(part 1 of 3)
# Autodesk Inventor assembly: ASSEMBLY_DUT_Ant_Rotator
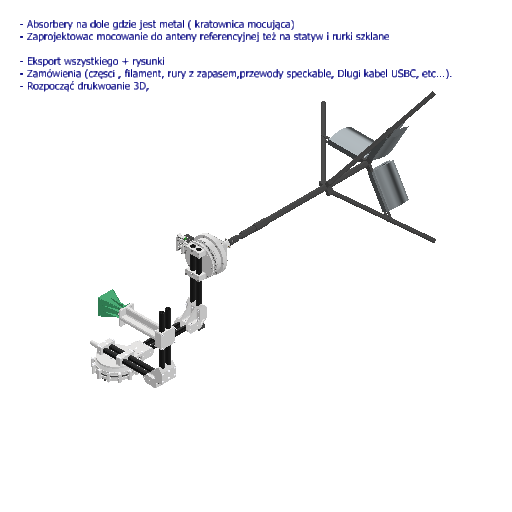
[picture p0: Inventor's stored thumbnail of the model, 512x512]
Saved by Autodesk Inventor 2027 (Build 310192060, 192F)
## iProperties
Created: 2026-01-06
Part Number: ASSEMBLY_DUT_Ant_Rotator
Document SubType Name: Assembly
Designer: User
Author: User
## Documents named in this file (62)
- C:\Users\lacze\OneDrive\_DRIVE_SYNCH_FILES\RF - Antenna Positioner\MCAD\1_V1\ASSEMBLY_DUT_ANT_POSITIONER_REVA\ASSEMBLY_DUT_Ant_Positioner.iam
- C:\Users\lacze\OneDrive\_DRIVE_SYNCH_FILES\RF - Antenna Positioner\MCAD\1_V1\__COTS_PARTS\COTS_CARBONCENTER_Fiberglass_Tube_27x24x383mm.ipt
- C:\Users\lacze\OneDrive\_DRIVE_SYNCH_FILES\RF - Antenna Positioner\MCAD\1_V1\__COTS_PARTS\COTS_GENERIC_6020_2RS_150x100x24mm_Ball_Bearing\COTS_GENERIC_6020_2RS_150x100x24mm_Ball_Bearing.ipt
- C:\Users\lacze\OneDrive\_DRIVE_SYNCH_FILES\RF - Antenna Positioner\MCAD\1_V1\ASSEMBLY_DUT_ANT_POSITIONER_REVA\3DP_PLA_A_Axis_Bearing_Base.ipt
- C:\Users\lacze\OneDrive\_DRIVE_SYNCH_FILES\RF - Antenna Positioner\MCAD\1_V1\ASSEMBLY_DUT_ANT_POSITIONER_REVA\3DP_PLA_A_Axis_Bearing_Base_Bearing_Locking_Ring.ipt
- C:\Users\lacze\OneDrive\_DRIVE_SYNCH_FILES\RF - Antenna Positioner\MCAD\1_V1\__CONTENT_CENTER_PARTS\en-US\ISO 7380-1\ISO 7380-1 - M4 x 40.ipt
- C:\Users\lacze\OneDrive\_DRIVE_SYNCH_FILES\RF - Antenna Positioner\MCAD\1_V1\__CONTENT_CENTER_PARTS\en-US\DIN 934\DIN 934 - M4 x 0,7.ipt
- C:\Users\lacze\OneDrive\_DRIVE_SYNCH_FILES\RF - Antenna Positioner\MCAD\1_V1\ASSEMBLY_DUT_ANT_POSITIONER_REVA\3DP_PLA_A_Axis_Rotating_Stage.ipt
- C:\Users\lacze\OneDrive\_DRIVE_SYNCH_FILES\RF - Antenna Positioner\MCAD\1_V1\ASSEMBLY_DUT_ANT_POSITIONER_REVA\3DP_PLA_A_Axis_Rotating_Stage_Mounting_Plate.ipt
- C:\Users\lacze\OneDrive\_DRIVE_SYNCH_FILES\RF - Antenna Positioner\MCAD\1_V1\__CONTENT_CENTER_PARTS\en-US\DIN 912\DIN 912 - M5 x 0,8 x 50 x 22.ipt
- C:\Users\lacze\OneDrive\_DRIVE_SYNCH_FILES\RF - Antenna Positioner\MCAD\1_V1\__CONTENT_CENTER_PARTS\en-US\DIN 934\DIN 934 - M5 x 0,8.ipt
- C:\Users\lacze\OneDrive\_DRIVE_SYNCH_FILES\RF - Antenna Positioner\MCAD\1_V1\__COTS_PARTS\COTS_GENERIC_HTD3M_24T_6mm_5mm_shaft_pulley.ipt
- C:\Users\lacze\OneDrive\_DRIVE_SYNCH_FILES\RF - Antenna Positioner\MCAD\1_V1\__COTS_PARTS\COTS_GENERIC_HTD3M_6mm_675mm_Closed_belt_A_Axis.ipt
- C:\Users\lacze\OneDrive\_DRIVE_SYNCH_FILES\RF - Antenna Positioner\MCAD\1_V1\ASSEMBLY_DUT_ANT_POSITIONER_REVA\3DP_PLA_A_Axis_Stepper_Mount.ipt
- C:\Users\lacze\OneDrive\_DRIVE_SYNCH_FILES\RF - Antenna Positioner\MCAD\1_V1\ASSEMBLY_DUT_ANT_POSITIONER_REVA\ASSEMBLY_HTD3M_Idler_A_Axis.iam
- C:\Users\lacze\OneDrive\_DRIVE_SYNCH_FILES\RF - Antenna Positioner\MCAD\1_V1\__CONTENT_CENTER_PARTS\en-US\DIN 125-1  A\DIN 125 - A 3,2.ipt
- C:\Users\lacze\OneDrive\_DRIVE_SYNCH_FILES\RF - Antenna Positioner\MCAD\1_V1\__CONTENT_CENTER_PARTS\en-US\ISO 7380-1\ISO 7380-1 - M3 x 16.ipt
- C:\Users\lacze\OneDrive\_DRIVE_SYNCH_FILES\RF - Antenna Positioner\MCAD\1_V1\ASSEMBLY_DUT_ANT_POSITIONER_REVA\3DP_PLA_A_Axis_Rotating_Stage_Fiberglass_pipes_mount_plate.ipt
- C:\Users\lacze\OneDrive\_DRIVE_SYNCH_FILES\RF - Antenna Positioner\MCAD\1_V1\ASSEMBLY_DUT_ANT_POSITIONER_REVA\3DP_PLA_A_Axis_Rotating_Stage_Fiberglass_pipes_mount_clamp.ipt
- C:\Users\lacze\OneDrive\_DRIVE_SYNCH_FILES\RF - Antenna Positioner\MCAD\1_V1\__CONTENT_CENTER_PARTS\en-US\DIN 912\DIN 912 - M4 x 0,7 x 20 x 18,25.ipt
- C:\Users\lacze\OneDrive\_DRIVE_SYNCH_FILES\RF - Antenna Positioner\MCAD\1_V1\__COTS_PARTS\COTS_MKS_SERVO42D_40mm.ipt
- C:\Users\lacze\OneDrive\_DRIVE_SYNCH_FILES\RF - Antenna Positioner\MCAD\1_V1\ASSEMBLY_DUT_ANT_POSITIONER_REVA\3DP_PLA_Fiberglass_Pipe_Corner_Bracket.ipt
- C:\Users\lacze\OneDrive\_DRIVE_SYNCH_FILES\RF - Antenna Positioner\MCAD\1_V1\ASSEMBLY_DUT_ANT_POSITIONER_REVA\3DP_PLA_Fiberglass_Pipe_Corner_Bracket_Clamp.ipt
- C:\Users\lacze\OneDrive\_DRIVE_SYNCH_FILES\RF - Antenna Positioner\MCAD\1_V1\__COTS_PARTS\COTS_DREMEC_8G206M6X50_M6x50_Nylon_Screw.ipt
- COTS_DREMEC_8G206M6X50_M6x50_Nylon_Screw.ipt
- C:\Users\lacze\OneDrive\_DRIVE_SYNCH_FILES\RF - Antenna Positioner\MCAD\1_V1\__COTS_PARTS\COTS_BOSSARD_1400444_M6_Nylon_Nut.ipt
- C:\Users\lacze\OneDrive\_DRIVE_SYNCH_FILES\RF - Antenna Positioner\MCAD\1_V1\ASSEMBLY_DUT_ANT_POSITIONER_REVA\3DP_PLA_Fiberglass_Pipe_Corner_Bracket_Clamp_and_B_axis_Stepper_Mount.ipt
- C:\Users\lacze\OneDrive\_DRIVE_SYNCH_FILES\RF - Antenna Positioner\MCAD\1_V1\__COTS_PARTS\COTS_GENERIC_HTD3M_20T_6mm_5mm_shaft_pulley.ipt
- C:\Users\lacze\OneDrive\_DRIVE_SYNCH_FILES\RF - Antenna Positioner\MCAD\1_V1\ASSEMBLY_DUT_ANT_POSITIONER_REVA\3DP_PLA_B_Axis_Main_Pulley.ipt
- C:\Users\lacze\OneDrive\_DRIVE_SYNCH_FILES\RF - Antenna Positioner\MCAD\1_V1\ASSEMBLY_DUT_ANT_POSITIONER_REVA\ASSEMBLY_HTD3M_Idler_B_Axis.iam
- C:\Users\lacze\OneDrive\_DRIVE_SYNCH_FILES\RF - Antenna Positioner\MCAD\1_V1\__COTS_PARTS\COTS_GENERIC_HTD3M_6mm_1530mm_Closed_belt_B_Axis.ipt
- C:\Users\lacze\OneDrive\_DRIVE_SYNCH_FILES\RF - Antenna Positioner\MCAD\1_V1\__CONTENT_CENTER_PARTS\en-US\DIN 912\DIN 912 - M4 x 0,7 x 35 x 20.ipt
- C:\Users\lacze\OneDrive\_DRIVE_SYNCH_FILES\RF - Antenna Positioner\MCAD\1_V1\__COTS_PARTS\COTS_GENERIC_6016_80x125x22mm_POM_Ball_Bearing\COTS_GENERIC_6016_80x125x22mm_POM_Ball_Bearing.ipt
- C:\Users\lacze\OneDrive\_DRIVE_SYNCH_FILES\RF - Antenna Positioner\MCAD\1_V1\ASSEMBLY_DUT_ANT_POSITIONER_REVA\3DP_PLA_B_Axis_Bearing_Mounting_Plate.ipt
- C:\Users\lacze\OneDrive\_DRIVE_SYNCH_FILES\RF - Antenna Positioner\MCAD\1_V1\ASSEMBLY_DUT_ANT_POSITIONER_REVA\ASSEMBLY_HTD3M_Idler_B_Axis_Top.iam
- C:\Users\lacze\OneDrive\_DRIVE_SYNCH_FILES\RF - Antenna Positioner\MCAD\1_V1\__COTS_PARTS\COTS_DREMEC_8G206V50126_M4x40_Nylon_Screw.ipt
- C:\Users\lacze\OneDrive\_DRIVE_SYNCH_FILES\RF - Antenna Positioner\MCAD\1_V1\__COTS_PARTS\COTS_BOSSARD_1400428_M4_Nylon_Nut.ipt
- C:\Users\lacze\OneDrive\_DRIVE_SYNCH_FILES\RF - Antenna Positioner\MCAD\1_V1\ASSEMBLY_DUT_ANT_POSITIONER_REVA\3DP_PLA_B_Axis_Rotating_Stage.ipt
- C:\Users\lacze\OneDrive\_DRIVE_SYNCH_FILES\RF - Antenna Positioner\MCAD\1_V1\__COTS_PARTS\COTS_BYTECHLAB_COAXIAL_FEED_HORN\COTS_BYTECHLAB_Coaxial_Feed_Horn.iam
- C:\Users\lacze\OneDrive\_DRIVE_SYNCH_FILES\RF - Antenna Positioner\MCAD\1_V1\ASSEMBLY_DUT_ANT_POSITIONER_REVA\3DP_PLA_B_Axis_Rotating_Stage_Fiberglass_pipes_mount_clamp.ipt
- C:\Users\lacze\OneDrive\_DRIVE_SYNCH_FILES\RF - Antenna Positioner\MCAD\1_V1\ASSEMBLY_DUT_ANT_POSITIONER_REVA\3DP_PLA_B_Axis_End_Cap.ipt
- C:\Users\lacze\OneDrive\_DRIVE_SYNCH_FILES\RF - Antenna Positioner\MCAD\1_V1\ASSEMBLY_DUT_ANT_POSITIONER_REVA\3DP_PLA_Antenna_Boom_Coax_Feed_Horn.ipt
- C:\Users\lacze\OneDrive\_DRIVE_SYNCH_FILES\RF - Antenna Positioner\MCAD\1_V1\ASSEMBLY_DUT_ANT_POSITIONER_REVA\3DP_PLA_Antenna_Boom_Fiberglass_Pipe_Clamp.ipt
- C:\Users\lacze\OneDrive\_DRIVE_SYNCH_FILES\RF - Antenna Positioner\MCAD\1_V1\__COTS_PARTS\COTS_GlareOne_A-275_Tripod\COTS_GlareOne_A-275_Tripod.iam
- C:\Users\lacze\OneDrive\_DRIVE_SYNCH_FILES\RF - Antenna Positioner\MCAD\1_V1\ASSEMBLY_DUT_ANT_POSITIONER_REVA\3DP_PLA_A_Axis_Bearing_Base_Tripod_Mount.ipt
- C:\Users\lacze\OneDrive\_DRIVE_SYNCH_FILES\RF - Antenna Positioner\MCAD\1_V1\__CONTENT_CENTER_PARTS\en-US\DIN 912\DIN 912 - M5 x 0,8 x 30 x 22.ipt
- C:\Users\lacze\OneDrive\_DRIVE_SYNCH_FILES\RF - Antenna Positioner\MCAD\1_V1\__COTS_PARTS\COTS_BOSSARD_1386786_M5_Threaded_Insert.ipt
- C:\Users\lacze\OneDrive\_DRIVE_SYNCH_FILES\RF - Antenna Positioner\MCAD\1_V1\__CONTENT_CENTER_PARTS\en-US\DIN 912\DIN 912 - M5 x 0,8 x 20 x 18.ipt
- C:\Users\lacze\OneDrive\_DRIVE_SYNCH_FILES\RF - Antenna Positioner\MCAD\1_V1\__COTS_PARTS\COTS_PROFOTO_Tripod_Sandbag.ipt
- C:\Users\lacze\OneDrive\_DRIVE_SYNCH_FILES\RF - Antenna Positioner\MCAD\1_V1\__COTS_PARTS\COTS_MKS_Cacable_1_0_PRO.ipt
- C:\Users\lacze\OneDrive\_DRIVE_SYNCH_FILES\RF - Antenna Positioner\MCAD\1_V1\__COTS_PARTS\COTS_GENERIC_5.6mm_DC_Jack.ipt
- C:\Users\lacze\OneDrive\_DRIVE_SYNCH_FILES\RF - Antenna Positioner\MCAD\1_V1\__COTS_PARTS\COTS_Profihot_HC-2-22x16_Zip_Tie_Anchor.ipt
- C:\Users\lacze\OneDrive\_DRIVE_SYNCH_FILES\RF - Antenna Positioner\MCAD\1_V1\__COTS_PARTS\COTS_BOSSARD_1386883_M4_Threaded_Insert\COTS_BOSSARD_1386883_M4_Threaded_Insert.ipt
- C:\Users\lacze\OneDrive\_DRIVE_SYNCH_FILES\RF - Antenna Positioner\MCAD\1_V1\__CONTENT_CENTER_PARTS\en-US\DIN 125-1  A\DIN 125 - A 4,3.ipt
- C:\Users\lacze\OneDrive\_DRIVE_SYNCH_FILES\RF - Antenna Positioner\MCAD\1_V1\__CONTENT_CENTER_PARTS\en-US\ISO 7380-1\ISO 7380-1 - M4 x 8.ipt
- C:\Users\lacze\OneDrive\_DRIVE_SYNCH_FILES\RF - Antenna Positioner\MCAD\1_V1\__CONTENT_CENTER_PARTS\en-US\ISO 7380-1\ISO 7380-1 - M4 x 16.ipt
- C:\Users\lacze\OneDrive\_DRIVE_SYNCH_FILES\RF - Antenna Positioner\MCAD\1_V1\__COTS_PARTS\COTS_DREMEC_8G206M5X08_M5x8_Nylon_Screw.ipt
- C:\Users\lacze\OneDrive\_DRIVE_SYNCH_FILES\RF - Antenna Positioner\MCAD\1_V1\ASSEMBLY_DUT_ANT_POSITIONER_REVA\3DP_PLA_B_Axis_Cable_Galnd.ipt
- C:\Users\lacze\OneDrive\_DRIVE_SYNCH_FILES\RF - Antenna Positioner\MCAD\1_V1\ASSEMBLY_DUT_ANT_POSITIONER_REVA\3DP_PLA_A_Axis_Idler_Stiffening_Bracket.ipt
- C:\Users\lacze\OneDrive\_DRIVE_SYNCH_FILES\RF - Antenna Positioner\MCAD\1_V1\ASSEMBLY_DUT_ANT_POSITIONER_REVA\3DP_PLA_B_Axis_Idler_Stiffening_Bracket.ipt
- C:\Users\lacze\OneDrive\_DRIVE_SYNCH_FILES\RF - Antenna Positioner\MCAD\1_V1\ASSEMBLY_DUT_ANT_POSITIONER_REVA\3DP_PLA_CANable_Mounting_Plate.ipt
- C:\Users\lacze\OneDrive\_DRIVE_SYNCH_FILES\RF - Antenna Positioner\MCAD\1_V1\__CONTENT_CENTER_PARTS\en-US\DIN 912\DIN 912 - M2 x 0,4 x 16 x 15.ipt
## Components (333 placed, 60 different names)
1. COTS_CARBONCENTER_Fiberglass_Tube_27x24x383mm:1 — Mate:124, Flush:1, Mate:210, Mate:214
2. COTS_GENERIC_6020_2RS_150x100x24mm_Ball_Bearing:1 — Mate:3, Mate:4, Mate:40, Mate:41, Mate:42, Mate:43
3. 3DP_PLA_A_Axis_Bearing_Base:1 — Mate:1, Mate:2, Mate:3, Mate:4, Mate:5, Mate:6, Mate:7, Mate:25, Mate:27, Mate:29, Mate:31, Mate:33, Mate:35, Mate:37, Mate:39, Angle:1, Angle:2, Angle:3, Angle:4, Angle:5, Angle:6, Angle:7, Angle:8, Angle:17, Mate:80, Mate:81, Mate:82, Mate:90, Mate:92, Mate:94, Angle:18, Angle:19, Angle:20, Mate:523, Mate:524, Mate:525, Mate:530, Mate:532, Mate:534, Mate:536, Mate:538, Mate:540, Mate:543, Mate:544, Mate:545, Mate:546, Mate:547, Mate:548, Mate:549, Mate:550, Mate:551, Mate:552, Mate:553, Mate:554, Mate:555, Mate:576, Angle:64, Mate:577, Flush:24, Angle:67
4. 3DP_PLA_A_Axis_Bearing_Base_Bearing_Locking_Ring:1 — Mate:5, Mate:6, Mate:7, Mate:8, Mate:9, Mate:10, Mate:11, Mate:12, Mate:13, Mate:14, Mate:15, Mate:16, Mate:17, Mate:18, Mate:19, Mate:20, Mate:21, Mate:22, Mate:23, Mate:24, Mate:26, Mate:28, Mate:30, Mate:32, Mate:34, Mate:36, Mate:38
5. COTS_MKS_SERVO42D_40mm:1 — Mate:77, Mate:107, Mate:108, Mate:109, Mate:110, Mate:112, Mate:114, Mate:116
6. 3DP_PLA_A_Axis_Rotating_Stage:1 — Mate:40, Mate:41, Mate:44, Mate:45, Mate:46, Mate:47, Mate:48, Mate:49, Mate:50, Mate:51, Mate:52, Mate:53, Mate:54, Mate:55, Mate:56, Mate:57, Mate:58, Mate:59, Mate:60, Mate:61, Mate:63, Mate:65, Mate:67, Mate:69, Mate:71, Mate:73, Mate:75, Mate:78, Mate:79, Mate:121, Mate:122, Mate:123, Mate:194, Mate:196, Mate:198, Mate:200, Mate:202, Mate:204, Mate:206, Mate:208, Angle:33, Angle:34, Angle:35, Angle:36, Angle:37, Angle:38, Angle:39, Angle:40
7. 3DP_PLA_A_Axis_Rotating_Stage_Mounting_Plate:1 — Mate:42, Mate:43, Mate:44, Mate:62, Mate:64, Mate:66, Mate:68, Mate:70, Mate:72, Mate:74, Mate:76, Angle:9, Angle:10, Angle:11, Angle:12, Angle:13, Angle:14, Angle:15, Angle:16
8. COTS_GENERIC_HTD3M_24T_6mm_5mm_shaft_pulley:1 — Mate:77, Mate:118, Mate:119
9. COTS_GENERIC_HTD3M_6mm_675mm_Closed_belt_A_Axis:1 — Mate:78, Mate:79, Mate:118, Mate:119
10. 3DP_PLA_A_Axis_Stepper_Mount:1 — Mate:80, Mate:81, Mate:82, Mate:83, Mate:84, Mate:85, Mate:86, Mate:87, Mate:88, Mate:89, Mate:91, Mate:93, Mate:95, Mate:96, Mate:97, Mate:98, Mate:107, Mate:108, Mate:109, Mate:111, Mate:113, Mate:115, Mate:117, Mate:563, Mate:564, Mate:565, Mate:574, Mate:575, Mate:600, Mate:602, Mate:616
11. ASSEMBLY_HTD3M_Idler_A_Axis:1 [sub-assembly] — Mate:96, Mate:98, Mate:594
12. ASSEMBLY_HTD3M_Idler_A_Axis:2 [sub-assembly] — Mate:95, Mate:97, Mate:592, Mate:593
13. 3DP_PLA_A_Axis_Rotating_Stage_Fiberglass_pipes_mount_plate:1 — Mate:121, Mate:122, Mate:123, Mate:124, Flush:1, Mate:125, Flush:2, Mate:127, Mate:128, Flush:3, Flush:4, Flush:5, Flush:6, Mate:154, Mate:156, Mate:158, Mate:160, Mate:162, Mate:164, Mate:166, Mate:168, Mate:170, Mate:172, Mate:174, Mate:176, Angle:21, Angle:22, Angle:23, Angle:24, Angle:25, Angle:26, Angle:27, Angle:28, Angle:29, Angle:30, Angle:31, Angle:32, Mate:177, Mate:178, Mate:179, Mate:180, Mate:181, Mate:182, Mate:183, Mate:184, Mate:185, Mate:186, Mate:187, Mate:188, Mate:189, Mate:190, Mate:191, Mate:192, Mate:193, Mate:195, Mate:197, Mate:199, Mate:201, Mate:203, Mate:205, Mate:207, Angle:41
14. COTS_CARBONCENTER_Fiberglass_Tube_27x24x383mm:2 — Mate:125, Flush:2, Mate:209, Mate:213, Flush:7
15. COTS_CARBONCENTER_Fiberglass_Tube_27x24x383mm:3 — Mate:211, Mate:240, Mate:242, Angle:42
16. 3DP_PLA_A_Axis_Rotating_Stage_Fiberglass_pipes_mount_clamp:1 — Mate:128, Flush:5, Flush:6, Mate:141, Mate:143, Mate:145, Mate:147, Mate:149, Mate:151, Mate:165, Mate:167, Mate:169, Mate:171, Mate:173, Mate:175
17. 3DP_PLA_A_Axis_Rotating_Stage_Fiberglass_pipes_mount_clamp:2 — Mate:127, Flush:3, Flush:4, Mate:129, Mate:130, Mate:131, Mate:132, Mate:133, Mate:134, Mate:135, Mate:136, Mate:137, Mate:138, Mate:139, Mate:140, Mate:142, Mate:144, Mate:146, Mate:148, Mate:150, Mate:152, Mate:153, Mate:155, Mate:157, Mate:159, Mate:161, Mate:163
18. COTS_CARBONCENTER_Fiberglass_Tube_27x24x383mm:4 — Mate:212, Mate:241, Mate:243, Mate:411
19. COTS_CARBONCENTER_Fiberglass_Tube_27x24x383mm:5 — Mate:251, Mate:254, Flush:11, Mate:406, Flush:19, Mate:407, Mate:409, Mate:590, Mate:591
20. COTS_CARBONCENTER_Fiberglass_Tube_27x24x383mm:6 — Mate:250, Mate:255, Flush:12, Mate:405, Mate:408, Mate:410
21. COTS_CARBONCENTER_Fiberglass_Tube_27x24x383mm:7 — Mate:253, Mate:256, Flush:13, Mate:501, Mate:503
22. COTS_CARBONCENTER_Fiberglass_Tube_27x24x383mm:8 — Mate:252, Mate:257, Flush:14, Mate:500, Flush:22, Mate:502
23. 3DP_PLA_Fiberglass_Pipe_Corner_Bracket:1 — Mate:209, Mate:210, Mate:211, Mate:212, Mate:215, Mate:228, Mate:229, Mate:230, Mate:231, Mate:232, Mate:233, Mate:240, Mate:241, Mate:244, Mate:270, Mate:271, Mate:272, Mate:273, Mate:274, Mate:275
24. 3DP_PLA_Fiberglass_Pipe_Corner_Bracket_Clamp:1 — Mate:213, Mate:214, Mate:215, Mate:216, Mate:217, Mate:218, Mate:219, Mate:220, Mate:221, Mate:222, Mate:223, Mate:224, Mate:225, Mate:226, Mate:227, Flush:7
25. 3DP_PLA_Fiberglass_Pipe_Corner_Bracket_Clamp_and_B_axis_Stepper_Mount:1 — Mate:242, Mate:243, Mate:244, Mate:245, Mate:248, Mate:249, Flush:8, Mate:258, Mate:259, Mate:260, Mate:261, Mate:262, Mate:263, Mate:264, Mate:265, Mate:266, Mate:267, Mate:268, Mate:269, Mate:331, Mate:332, Mate:333, Mate:334, Mate:336, Mate:342, Mate:344, Mate:346, Mate:348, Angle:43, Mate:581, Mate:582, Mate:584, Mate:585, Mate:611, Mate:613
26. COTS_MKS_SERVO42D_40mm:2 — Mate:245, Mate:247, Mate:248, Mate:249, Mate:336, Mate:341, Mate:343, Mate:345, Mate:347, Angle:65
27. COTS_GENERIC_HTD3M_20T_6mm_5mm_shaft_pulley:1 — Mate:247, Flush:8, Mate:335, Mate:337
28. 3DP_PLA_Fiberglass_Pipe_Corner_Bracket:2 — Mate:250, Mate:251, Mate:252, Mate:253, Flush:9, Flush:10, Mate:306, Mate:307, Mate:308, Mate:309, Mate:310, Mate:311, Mate:312, Mate:313, Mate:314, Mate:315, Mate:316, Mate:317, Angle:54
29. 3DP_PLA_Fiberglass_Pipe_Corner_Bracket_Clamp:2 — Mate:254, Mate:255, Flush:10, Flush:11, Flush:12, Mate:282, Mate:283, Mate:284, Mate:285, Mate:286, Mate:287, Mate:300, Mate:301, Mate:302, Mate:303, Mate:304, Mate:305
30. 3DP_PLA_Fiberglass_Pipe_Corner_Bracket_Clamp:3 — Mate:256, Mate:257, Flush:9, Flush:13, Flush:14, Mate:288, Mate:289, Mate:290, Mate:291, Mate:292, Mate:293, Mate:294, Mate:295, Mate:296, Mate:297, Mate:298, Mate:299
31. 3DP_PLA_B_Axis_Main_Pulley:1 — Mate:339, Mate:340, Mate:357, Mate:358, Mate:359, Mate:360, Mate:404, Mate:460, Mate:461, Mate:462, Mate:463, Mate:464, Mate:465, Mate:466, Mate:467, Mate:468, Mate:469, Mate:470, Mate:471, Mate:472, Mate:486, Mate:487, Mate:488, Mate:489, Mate:490, Mate:491, Mate:492, Mate:493
32. ASSEMBLY_HTD3M_Idler_B_Axis:1 [sub-assembly] — Mate:331, Mate:334, Mate:605
33. ASSEMBLY_HTD3M_Idler_B_Axis:2 [sub-assembly] — Mate:332, Mate:333, Mate:603, Mate:604
34. COTS_GENERIC_HTD3M_6mm_1530mm_Closed_belt_B_Axis:1 — Mate:335, Mate:337, Mate:339, Mate:340, Angle:42
35. COTS_GENERIC_6016_80x125x22mm_POM_Ball_Bearing:1 — Mate:357, Mate:358, Flush:17, Mate:362, Mate:485
36. COTS_GENERIC_6016_80x125x22mm_POM_Ball_Bearing:2 — Mate:359, Mate:360, Mate:361, Flush:16, Mate:403
37. 3DP_PLA_B_Axis_Bearing_Mounting_Plate:1 — Mate:361, Flush:16, Angle:43, Flush:18, Mate:363, Mate:364, Mate:365, Mate:366, Mate:367, Mate:368, Mate:369, Mate:370, Mate:383, Mate:384, Mate:385, Mate:386, Mate:387, Mate:388, Mate:397, Mate:411, Angle:54
38. 3DP_PLA_B_Axis_Bearing_Mounting_Plate:2 — Flush:17, Mate:362, Flush:18, Mate:371, Mate:372, Mate:373, Mate:374, Mate:375, Mate:376, Mate:377, Mate:378, Mate:379, Mate:380, Mate:381, Mate:382, Mate:395, Mate:396, Mate:399, Mate:400, Mate:586, Angle:66, Mate:587, Mate:588
39. ASSEMBLY_HTD3M_Idler_B_Axis_Top:1 [sub-assembly] — Mate:363, Mate:365
40. ASSEMBLY_HTD3M_Idler_B_Axis_Top:2 [sub-assembly] — Mate:364, Mate:366
41. 3DP_PLA_B_Axis_Rotating_Stage:1 — Mate:403, Mate:404, Mate:405, Mate:406, Flush:19, Flush:20, Flush:21, Mate:436, Mate:437, Mate:438, Mate:439, Mate:440, Mate:441, Mate:442, Mate:443, Mate:444, Mate:445, Mate:446, Mate:447, Angle:44, Angle:45, Angle:46, Angle:47, Angle:48, Angle:49, Angle:50, Angle:51, Angle:52, Angle:53, Mate:460, Mate:473, Mate:474, Mate:475, Mate:476, Mate:477, Mate:478, Angle:55, Angle:56, Angle:57, Angle:58, Angle:59, Angle:60
42. COTS_BYTECHLAB_Coaxial_Feed_Horn:1 [sub-assembly] — Mate:520, Mate:521, Mate:522
43. 3DP_PLA_B_Axis_Rotating_Stage_Fiberglass_pipes_mount_clamp:1 — Mate:407, Mate:408, Flush:20, Mate:412, Mate:413, Mate:414, Mate:415, Mate:416, Mate:417, Mate:430, Mate:431, Mate:432, Mate:433, Mate:434, Mate:435
44. 3DP_PLA_B_Axis_Rotating_Stage_Fiberglass_pipes_mount_clamp:2 — Mate:409, Mate:410, Flush:21, Mate:418, Mate:419, Mate:420, Mate:421, Mate:422, Mate:423, Mate:424, Mate:425, Mate:426, Mate:427, Mate:428, Mate:429
45. 3DP_PLA_B_Axis_End_Cap:1 — Mate:485, Mate:486, Mate:487, Mate:494, Mate:495, Mate:496, Angle:61, Angle:62, Angle:63
46. 3DP_PLA_Antenna_Boom_Coax_Feed_Horn:1 — Mate:500, Mate:501, Flush:22, Flush:23, Mate:504, Mate:505, Mate:506, Mate:507, Mate:508, Mate:509, Mate:510, Mate:511, Mate:520, Mate:521, Mate:522
47. 3DP_PLA_Antenna_Boom_Fiberglass_Pipe_Clamp:1 — Mate:502, Mate:503, Flush:23, Mate:512, Mate:513, Mate:514, Mate:515
48. COTS_GlareOne_A-275_Tripod:1 [sub-assembly] — Mate:526, Mate:527, Mate:560, Mate:561, Mate:562, Angle:67
49. 3DP_PLA_A_Axis_Bearing_Base_Tripod_Mount:1 — Mate:523, Mate:524, Mate:525, Mate:526, Mate:527, Mate:528, Mate:529, Mate:531, Mate:533, Mate:535, Mate:537, Mate:539, Mate:541, Mate:542, Mate:556, Mate:557
50. COTS_MKS_Cacable_1_0_PRO:1 — Mate:563, Mate:564, Mate:565, Mate:614, Mate:615
51. COTS_GENERIC_5.6mm_DC_Jack:1 — Mate:574, Mate:575
52. COTS_Profihot_HC-2-22x16_Zip_Tie_Anchor:1 — Mate:576, Angle:64, Mate:578, Mate:579, Mate:580
53. COTS_Profihot_HC-2-22x16_Zip_Tie_Anchor:2 — Mate:581, Angle:65, Mate:583
54. COTS_Profihot_HC-2-22x16_Zip_Tie_Anchor:3 — Mate:586, Angle:66, Mate:587, Mate:589
55. COTS_DREMEC_8G206M5X08_M5x8_Nylon_Screw:1 — Mate:588, Mate:589
56. 3DP_PLA_B_Axis_Cable_Galnd:1 — Mate:590, Mate:591
57. 3DP_PLA_A_Axis_Idler_Stiffening_Bracket:1 — Mate:592, Mate:593, Mate:594, Mate:595, Mate:596, Mate:597, Mate:598, Mate:599, Mate:601
58. 3DP_PLA_B_Axis_Idler_Stiffening_Bracket:1 — Mate:603, Mate:604, Mate:605, Mate:606, Mate:607, Mate:608, Mate:609, Mate:610, Mate:612
59. 3DP_PLA_CANable_Mounting_Plate:1 — Mate:614, Mate:615, Mate:616, Mate:617, Mate:618, Mate:619, Mate:620, Mate:621, Mate:622, Mate:623, Mate:624
60. DIN 912 - replaced by DIN EN ISO 4762 M2 x 16:1 — Mate:617, Mate:618
61. DIN 912 - replaced by DIN EN ISO 4762 M2 x 16:2 — Mate:619, Mate:620
62. DIN 912 - replaced by DIN EN ISO 4762 M2 x 16:3 — Mate:621, Mate:622
63. DIN 912 - replaced by DIN EN ISO 4762 M2 x 16:4 — Mate:623, Mate:624
64. DIN 912 - replaced by DIN EN ISO 4762 M4 x 35:3 — Mate:595, Mate:596
65. DIN 934 - replaced by DIN EN 24032/28673/28674 M4:25 — Mate:599, Mate:600
66. DIN 912 - replaced by DIN EN ISO 4762 M4 x 35:4 — Mate:597, Mate:598
67. DIN 934 - replaced by DIN EN 24032/28673/28674 M4:26 — Mate:601, Mate:602
68. ISO 7380-1 M4 x 40:12 — Mate:606, Mate:607
69. DIN 934 - replaced by DIN EN 24032/28673/28674 M4:27 — Mate:610, Mate:611
70. ISO 7380-1 M4 x 40:13 — Mate:608, Mate:609
71. DIN 934 - replaced by DIN EN 24032/28673/28674 M4:28 — Mate:612, Mate:613
72. COTS_BOSSARD_1386883_M4_Threaded_Insert:1 — Mate:577, Flush:24, Mate:578
73. DIN 125-1 A A 4,3:1 — Mate:579, Mate:580, Insert:9
74. ISO 7380-1 M4 x 8:1 — Insert:9
75. DIN 125-1 A A 4,3:2 — Mate:582, Mate:583, Insert:10
76. ISO 7380-1 M4 x 16:1 — Insert:10
77. DIN 125-1 A A 4,3:3 — Mate:584, Mate:585, Insert:11
78. DIN 934 - replaced by DIN EN 24032/28673/28674 M4:24 — Insert:11
79. DIN 934 - replaced by DIN EN 24032/28673/28674 M5:27 — Mate:554, Mate:555
80. DIN 934 - replaced by DIN EN 24032/28673/28674 M5:26 — Mate:552, Mate:553
81. DIN 934 - replaced by DIN EN 24032/28673/28674 M5:25 — Mate:550, Mate:551
82. DIN 934 - replaced by DIN EN 24032/28673/28674 M5:24 — Mate:548, Mate:549
83. DIN 934 - replaced by DIN EN 24032/28673/28674 M5:23 — Mate:546, Mate:547
84. DIN 934 - replaced by DIN EN 24032/28673/28674 M5:22 — Mate:544, Mate:545
85. DIN 912 - replaced by DIN EN ISO 4762 M5 x 30:7 — Mate:540, Mate:541
86. DIN 912 - replaced by DIN EN ISO 4762 M5 x 30:6 — Mate:538, Mate:539
87. DIN 912 - replaced by DIN EN ISO 4762 M5 x 30:5 — Mate:536, Mate:537
88. DIN 912 - replaced by DIN EN ISO 4762 M5 x 30:4 — Mate:534, Mate:535
89. DIN 912 - replaced by DIN EN ISO 4762 M5 x 30:3 — Mate:532, Mate:533
90. DIN 912 - replaced by DIN EN ISO 4762 M5 x 30:2 — Mate:530, Mate:531
91. DIN 934 - replaced by DIN EN 24032/28673/28674 M5:21 — Mate:542, Mate:543
92. DIN 912 - replaced by DIN EN ISO 4762 M5 x 30:1 — Mate:528, Mate:529
93. COTS_BOSSARD_1400444_M6_Nylon_Nut:66 — Mate:513, Mate:517
94. COTS_BOSSARD_1400444_M6_Nylon_Nut:65 — Mate:514, Mate:519
95. COTS_BOSSARD_1400444_M6_Nylon_Nut:64 — Mate:515, Mate:516
96. COTS_BOSSARD_1400444_M6_Nylon_Nut:63 — Mate:512, Mate:518
97. COTS_DREMEC_8G206M6X50_M6x50_Nylon_Screw:66 — Mate:507, Mate:508, Mate:516
98. COTS_DREMEC_8G206M6X50_M6x50_Nylon_Screw:65 — Mate:506, Mate:511, Mate:519
99. COTS_DREMEC_8G206M6X50_M6x50_Nylon_Screw:64 — Mate:505, Mate:509, Mate:517
100. COTS_DREMEC_8G206M6X50_M6x50_Nylon_Screw:63 — Mate:504, Mate:510, Mate:518
101. COTS_BOSSARD_1400444_M6_Nylon_Nut:62 — Mate:495, Mate:498, Angle:62
102. COTS_BOSSARD_1400444_M6_Nylon_Nut:61 — Mate:494, Mate:499, Angle:61
103. COTS_BOSSARD_1400444_M6_Nylon_Nut:60 — Mate:496, Mate:497, Angle:63
104. COTS_DREMEC_8G206M6X50_M6x50_Nylon_Screw:62 — Mate:488, Mate:493, Mate:497
105. COTS_DREMEC_8G206M6X50_M6x50_Nylon_Screw:61 — Mate:489, Mate:491, Mate:499
106. COTS_DREMEC_8G206M6X50_M6x50_Nylon_Screw:60 — Mate:490, Mate:492, Mate:498
107. COTS_BOSSARD_1400444_M6_Nylon_Nut:59 — Mate:477, Mate:479, Angle:60
108. COTS_BOSSARD_1400444_M6_Nylon_Nut:58 — Mate:478, Mate:480, Angle:59
109. COTS_BOSSARD_1400444_M6_Nylon_Nut:57 — Mate:476, Mate:484, Angle:58
110. COTS_BOSSARD_1400444_M6_Nylon_Nut:56 — Mate:475, Mate:483, Angle:57
111. COTS_BOSSARD_1400444_M6_Nylon_Nut:55 — Mate:473, Mate:481, Angle:55
112. COTS_BOSSARD_1400444_M6_Nylon_Nut:54 — Mate:474, Mate:482, Angle:56
113. COTS_DREMEC_8G206M6X50_M6x50_Nylon_Screw:59 — Mate:465, Mate:470, Mate:484
114. COTS_DREMEC_8G206M6X50_M6x50_Nylon_Screw:58 — Mate:466, Mate:469, Mate:483
115. COTS_DREMEC_8G206M6X50_M6x50_Nylon_Screw:57 — Mate:464, Mate:471, Mate:480
116. COTS_DREMEC_8G206M6X50_M6x50_Nylon_Screw:56 — Mate:463, Mate:468, Mate:482
117. COTS_DREMEC_8G206M6X50_M6x50_Nylon_Screw:55 — Mate:461, Mate:472, Mate:479
118. COTS_DREMEC_8G206M6X50_M6x50_Nylon_Screw:54 — Mate:462, Mate:467, Mate:481
119. COTS_BOSSARD_1400444_M6_Nylon_Nut:53 — Mate:439, Mate:459, Angle:45
120. COTS_BOSSARD_1400444_M6_Nylon_Nut:52 — Mate:440, Mate:457, Angle:46
121. COTS_BOSSARD_1400444_M6_Nylon_Nut:51 — Mate:445, Mate:450
122. COTS_BOSSARD_1400444_M6_Nylon_Nut:50 — Mate:438, Mate:454, Angle:48
123. COTS_BOSSARD_1400444_M6_Nylon_Nut:49 — Mate:441, Mate:455, Angle:49
124. COTS_BOSSARD_1400444_M6_Nylon_Nut:48 — Mate:447, Mate:448, Angle:51
125. COTS_BOSSARD_1400444_M6_Nylon_Nut:47 — Mate:437, Mate:456, Angle:47
126. COTS_BOSSARD_1400444_M6_Nylon_Nut:46 — Mate:442, Mate:451
127. COTS_BOSSARD_1400444_M6_Nylon_Nut:45 — Mate:446, Mate:449, Angle:53
128. COTS_BOSSARD_1400444_M6_Nylon_Nut:44 — Mate:436, Mate:458, Angle:44
129. COTS_BOSSARD_1400444_M6_Nylon_Nut:43 — Mate:443, Mate:452, Angle:52
130. COTS_BOSSARD_1400444_M6_Nylon_Nut:42 — Mate:444, Mate:453, Angle:50
131. COTS_DREMEC_8G206M6X50_M6x50_Nylon_Screw:53 — Mate:423, Mate:426, Mate:456
132. COTS_DREMEC_8G206M6X50_M6x50_Nylon_Screw:52 — Mate:422, Mate:424, Mate:454
133. COTS_DREMEC_8G206M6X50_M6x50_Nylon_Screw:51 — Mate:421, Mate:429, Mate:459
134. COTS_DREMEC_8G206M6X50_M6x50_Nylon_Screw:50 — Mate:420, Mate:425, Mate:455
135. COTS_DREMEC_8G206M6X50_M6x50_Nylon_Screw:49 — Mate:419, Mate:427, Mate:457
136. COTS_DREMEC_8G206M6X50_M6x50_Nylon_Screw:48 — Mate:418, Mate:428, Mate:458
137. COTS_DREMEC_8G206M6X50_M6x50_Nylon_Screw:47 — Mate:417, Mate:434, Mate:449
138. COTS_DREMEC_8G206M6X50_M6x50_Nylon_Screw:46 — Mate:416, Mate:433, Mate:451
139. COTS_DREMEC_8G206M6X50_M6x50_Nylon_Screw:45 — Mate:415, Mate:435, Mate:452
140. COTS_DREMEC_8G206M6X50_M6x50_Nylon_Screw:44 — Mate:412, Mate:432, Mate:450
141. COTS_DREMEC_8G206M6X50_M6x50_Nylon_Screw:43 — Mate:413, Mate:430, Mate:448
142. COTS_DREMEC_8G206M6X50_M6x50_Nylon_Screw:42 — Mate:414, Mate:431, Mate:453
143. COTS_BOSSARD_1400428_M4_Nylon_Nut:2 — Mate:400, Mate:402
144. COTS_BOSSARD_1400428_M4_Nylon_Nut:1 — Mate:399, Mate:401
145. COTS_BOSSARD_1400444_M6_Nylon_Nut:30 — Mate:386, Mate:392
146. COTS_BOSSARD_1400444_M6_Nylon_Nut:29 — Mate:385, Mate:393
147. COTS_BOSSARD_1400444_M6_Nylon_Nut:28 — Mate:387, Mate:390
148. COTS_BOSSARD_1400444_M6_Nylon_Nut:27 — Mate:384, Mate:391
149. COTS_BOSSARD_1400444_M6_Nylon_Nut:26 — Mate:388, Mate:394
150. COTS_BOSSARD_1400444_M6_Nylon_Nut:25 — Mate:383, Mate:389
151. COTS_DREMEC_8G206M6X50_M6x50_Nylon_Screw:30 — Mate:376, Mate:379, Mate:392
152. COTS_DREMEC_8G206M6X50_M6x50_Nylon_Screw:29 — Mate:375, Mate:382, Mate:394
153. COTS_DREMEC_8G206M6X50_M6x50_Nylon_Screw:28 — Mate:374, Mate:378, Mate:389
154. COTS_DREMEC_8G206M6X50_M6x50_Nylon_Screw:27 — Mate:373, Mate:380, Mate:391
155. COTS_DREMEC_8G206M6X50_M6x50_Nylon_Screw:26 — Mate:372, Mate:377, Mate:390
156. COTS_DREMEC_8G206M6X50_M6x50_Nylon_Screw:25 — Mate:371, Mate:381, Mate:393
157. COTS_DREMEC_8G206V50126_M4x40_Screw:2 — Mate:368, Mate:369, Mate:402
158. COTS_DREMEC_8G206V50126_M4x40_Screw:1 — Mate:367, Mate:370, Mate:401
159. ISO 7380-1 M3 x 16:8 — Insert:8
160. ISO 7380-1 M3 x 16:7 — Insert:7
161. ISO 7380-1 M3 x 16:6 — Insert:6
162. DIN 125-1 A A 3,2:8 — Mate:347, Mate:348, Insert:8
163. DIN 125-1 A A 3,2:7 — Mate:345, Mate:346, Insert:7
164. DIN 125-1 A A 3,2:6 — Mate:343, Mate:344, Insert:6
165. ISO 7380-1 M3 x 16:5 — Insert:5
166. DIN 125-1 A A 3,2:5 — Mate:341, Mate:342, Insert:5
167. COTS_BOSSARD_1400444_M6_Nylon_Nut:24 — Mate:317, Mate:328
168. COTS_BOSSARD_1400444_M6_Nylon_Nut:23 — Mate:316, Mate:329
169. COTS_BOSSARD_1400444_M6_Nylon_Nut:22 — Mate:315, Mate:326
170. COTS_BOSSARD_1400444_M6_Nylon_Nut:21 — Mate:314, Mate:327
171. COTS_BOSSARD_1400444_M6_Nylon_Nut:20 — Mate:313, Mate:325
172. COTS_BOSSARD_1400444_M6_Nylon_Nut:19 — Mate:312, Mate:324
173. COTS_BOSSARD_1400444_M6_Nylon_Nut:18 — Mate:308, Mate:321
174. COTS_BOSSARD_1400444_M6_Nylon_Nut:17 — Mate:310, Mate:322
175. COTS_BOSSARD_1400444_M6_Nylon_Nut:16 — Mate:309, Mate:323
176. COTS_BOSSARD_1400444_M6_Nylon_Nut:15 — Mate:311, Mate:320
177. COTS_BOSSARD_1400444_M6_Nylon_Nut:14 — Mate:307, Mate:318
178. COTS_BOSSARD_1400444_M6_Nylon_Nut:13 — Mate:306, Mate:319
179. COTS_DREMEC_8G206M6X50_M6x50_Nylon_Screw:24 — Mate:293, Mate:299, Mate:324
180. COTS_DREMEC_8G206M6X50_M6x50_Nylon_Screw:23 — Mate:292, Mate:297, Mate:327
181. COTS_DREMEC_8G206M6X50_M6x50_Nylon_Screw:22 — Mate:290, Mate:294, Mate:329
182. COTS_DREMEC_8G206M6X50_M6x50_Nylon_Screw:21 — Mate:291, Mate:298, Mate:328
183. COTS_DREMEC_8G206M6X50_M6x50_Nylon_Screw:20 — Mate:289, Mate:295, Mate:326
184. COTS_DREMEC_8G206M6X50_M6x50_Nylon_Screw:19 — Mate:288, Mate:296, Mate:325
185. COTS_DREMEC_8G206M6X50_M6x50_Nylon_Screw:18 — Mate:287, Mate:301, Mate:320
186. COTS_DREMEC_8G206M6X50_M6x50_Nylon_Screw:17 — Mate:286, Mate:300, Mate:318
187. COTS_DREMEC_8G206M6X50_M6x50_Nylon_Screw:16 — Mate:283, Mate:302, Mate:321
188. COTS_DREMEC_8G206M6X50_M6x50_Nylon_Screw:15 — Mate:284, Mate:305, Mate:319
189. COTS_DREMEC_8G206M6X50_M6x50_Nylon_Screw:14 — Mate:285, Mate:303, Mate:322
190. COTS_DREMEC_8G206M6X50_M6x50_Nylon_Screw:13 — Mate:282, Mate:304, Mate:323
191. COTS_BOSSARD_1400444_M6_Nylon_Nut:12 — Mate:270, Mate:280
192. COTS_BOSSARD_1400444_M6_Nylon_Nut:11 — Mate:271, Mate:281
193. COTS_BOSSARD_1400444_M6_Nylon_Nut:10 — Mate:272, Mate:278
194. COTS_BOSSARD_1400444_M6_Nylon_Nut:9 — Mate:273, Mate:279
195. COTS_BOSSARD_1400444_M6_Nylon_Nut:8 — Mate:275, Mate:276
196. COTS_BOSSARD_1400444_M6_Nylon_Nut:7 — Mate:274, Mate:277
197. COTS_DREMEC_8G206M6X50_M6x50_Nylon_Screw:12 — Mate:263, Mate:268, Mate:278
198. COTS_DREMEC_8G206M6X50_M6x50_Nylon_Screw:11 — Mate:262, Mate:265, Mate:279
199. COTS_DREMEC_8G206M6X50_M6x50_Nylon_Screw:10 — Mate:261, Mate:269, Mate:280
200. COTS_DREMEC_8G206M6X50_M6x50_Nylon_Screw:9 — Mate:260, Mate:264, Mate:281
201. COTS_DREMEC_8G206M6X50_M6x50_Nylon_Screw:8 — Mate:259, Mate:266, Mate:276
202. COTS_DREMEC_8G206M6X50_M6x50_Nylon_Screw:7 — Mate:258, Mate:267, Mate:277
203. COTS_BOSSARD_1400444_M6_Nylon_Nut:6 — Mate:233, Mate:239
204. COTS_BOSSARD_1400444_M6_Nylon_Nut:5 — Mate:230, Mate:237
205. COTS_BOSSARD_1400444_M6_Nylon_Nut:4 — Mate:231, Mate:236
206. COTS_BOSSARD_1400444_M6_Nylon_Nut:3 — Mate:232, Mate:238
207. COTS_BOSSARD_1400444_M6_Nylon_Nut:2 — Mate:229, Mate:235
208. COTS_BOSSARD_1400444_M6_Nylon_Nut:1 — Mate:228, Mate:234
209. COTS_DREMEC_8G206M6X50_M6x50_Nylon_Screw:6 — Mate:221, Mate:227, Mate:239
210. COTS_DREMEC_8G206M6X50_M6x50_Nylon_Screw:5 — Mate:220, Mate:226, Mate:238
211. COTS_DREMEC_8G206M6X50_M6x50_Nylon_Screw:4 — Mate:219, Mate:225, Mate:236
212. COTS_DREMEC_8G206M6X50_M6x50_Nylon_Screw:3 — Mate:216, Mate:223, Mate:234
213. COTS_DREMEC_8G206M6X50_M6x50_Nylon_Screw:2 — Mate:218, Mate:224, Mate:237
214. COTS_DREMEC_8G206M6X50_M6x50_Nylon_Screw:1 — Mate:217, Mate:222, Mate:235
215. DIN 934 - replaced by DIN EN 24032/28673/28674 M4:21 — Mate:207, Mate:208, Angle:37
216. DIN 934 - replaced by DIN EN 24032/28673/28674 M4:20 — Mate:205, Mate:206, Angle:38
217. DIN 934 - replaced by DIN EN 24032/28673/28674 M4:19 — Mate:203, Mate:204, Angle:39
218. DIN 934 - replaced by DIN EN 24032/28673/28674 M4:18 — Mate:201, Mate:202, Angle:40
219. DIN 934 - replaced by DIN EN 24032/28673/28674 M4:17 — Mate:199, Mate:200, Angle:33
220. DIN 934 - replaced by DIN EN 24032/28673/28674 M4:16 — Mate:197, Mate:198, Angle:36
221. DIN 934 - replaced by DIN EN 24032/28673/28674 M4:15 — Mate:195, Mate:196, Angle:34
222. DIN 912 - replaced by DIN EN ISO 4762 M4 x 20:8 — Mate:191, Mate:192
223. DIN 912 - replaced by DIN EN ISO 4762 M4 x 20:7 — Mate:189, Mate:190
224. DIN 912 - replaced by DIN EN ISO 4762 M4 x 20:6 — Mate:187, Mate:188
225. DIN 912 - replaced by DIN EN ISO 4762 M4 x 20:5 — Mate:185, Mate:186
226. DIN 912 - replaced by DIN EN ISO 4762 M4 x 20:4 — Mate:183, Mate:184
227. DIN 912 - replaced by DIN EN ISO 4762 M4 x 20:3 — Mate:181, Mate:182
228. DIN 912 - replaced by DIN EN ISO 4762 M4 x 20:2 — Mate:179, Mate:180
229. DIN 934 - replaced by DIN EN 24032/28673/28674 M4:14 — Mate:193, Mate:194, Angle:35
230. DIN 912 - replaced by DIN EN ISO 4762 M4 x 20:1 — Mate:177, Mate:178
231. DIN 934 - replaced by DIN EN 24032/28673/28674 M5:20 — Mate:175, Mate:176, Angle:27
232. DIN 934 - replaced by DIN EN 24032/28673/28674 M5:19 — Mate:173, Mate:174, Angle:28
233. DIN 934 - replaced by DIN EN 24032/28673/28674 M5:18 — Mate:171, Mate:172, Angle:29
234. DIN 934 - replaced by DIN EN 24032/28673/28674 M5:17 — Mate:169, Mate:170, Angle:30
235. DIN 934 - replaced by DIN EN 24032/28673/28674 M5:16 — Mate:167, Mate:168, Angle:31
236. DIN 934 - replaced by DIN EN 24032/28673/28674 M5:15 — Mate:165, Mate:166, Angle:32
237. DIN 934 - replaced by DIN EN 24032/28673/28674 M5:14 — Mate:163, Mate:164, Angle:24
238. DIN 934 - replaced by DIN EN 24032/28673/28674 M5:13 — Mate:161, Mate:162, Angle:23
239. DIN 934 - replaced by DIN EN 24032/28673/28674 M5:12 — Mate:159, Mate:160, Angle:22
240. DIN 934 - replaced by DIN EN 24032/28673/28674 M5:11 — Mate:157, Mate:158, Angle:25
241. DIN 934 - replaced by DIN EN 24032/28673/28674 M5:10 — Mate:155, Mate:156, Angle:26
242. DIN 912 - replaced by DIN EN ISO 4762 M5 x 50:20 — Mate:151, Mate:152
243. DIN 912 - replaced by DIN EN ISO 4762 M5 x 50:19 — Mate:149, Mate:150
244. DIN 912 - replaced by DIN EN ISO 4762 M5 x 50:18 — Mate:147, Mate:148
245. DIN 912 - replaced by DIN EN ISO 4762 M5 x 50:17 — Mate:145, Mate:146
246. DIN 912 - replaced by DIN EN ISO 4762 M5 x 50:16 — Mate:143, Mate:144
247. DIN 912 - replaced by DIN EN ISO 4762 M5 x 50:15 — Mate:141, Mate:142
248. DIN 912 - replaced by DIN EN ISO 4762 M5 x 50:14 — Mate:139, Mate:140
249. DIN 912 - replaced by DIN EN ISO 4762 M5 x 50:13 — Mate:137, Mate:138
250. DIN 912 - replaced by DIN EN ISO 4762 M5 x 50:12 — Mate:135, Mate:136
251. DIN 912 - replaced by DIN EN ISO 4762 M5 x 50:11 — Mate:133, Mate:134
252. DIN 912 - replaced by DIN EN ISO 4762 M5 x 50:10 — Mate:131, Mate:132
253. DIN 934 - replaced by DIN EN 24032/28673/28674 M5:9 — Mate:153, Mate:154, Angle:21
254. DIN 912 - replaced by DIN EN ISO 4762 M5 x 50:9 — Mate:129, Mate:130
255. DIN 934 - replaced by DIN EN 24032/28673/28674 M4:11 — Mate:93, Mate:94, Angle:20
256. DIN 934 - replaced by DIN EN 24032/28673/28674 M4:10 — Mate:91, Mate:92, Angle:19
257. ISO 7380-1 M4 x 40:11 — Mate:87, Mate:88
258. ISO 7380-1 M4 x 40:10 — Mate:85, Mate:86
259. DIN 934 - replaced by DIN EN 24032/28673/28674 M4:9 — Mate:89, Mate:90, Angle:18
260. ISO 7380-1 M4 x 40:9 — Mate:83, Mate:84
261. ISO 7380-1 M3 x 16:4 — Insert:4
262. ISO 7380-1 M3 x 16:3 — Insert:3
263. ISO 7380-1 M3 x 16:2 — Insert:2
264. DIN 125-1 A A 3,2:4 — Mate:116, Mate:117, Insert:4
265. DIN 125-1 A A 3,2:3 — Mate:114, Mate:115, Insert:3
266. DIN 125-1 A A 3,2:2 — Mate:112, Mate:113, Insert:2
267. ISO 7380-1 M3 x 16:1 — Insert:1
268. DIN 125-1 A A 3,2:1 — Mate:110, Mate:111, Insert:1
269. DIN 934 - replaced by DIN EN 24032/28673/28674 M5:8 — Mate:75, Mate:76, Angle:15
270. DIN 934 - replaced by DIN EN 24032/28673/28674 M5:7 — Mate:73, Mate:74, Angle:14
271. DIN 934 - replaced by DIN EN 24032/28673/28674 M5:6 — Mate:71, Mate:72, Angle:13
272. DIN 934 - replaced by DIN EN 24032/28673/28674 M5:5 — Mate:69, Mate:70, Angle:12
273. DIN 934 - replaced by DIN EN 24032/28673/28674 M5:4 — Mate:67, Mate:68, Angle:11
274. DIN 934 - replaced by DIN EN 24032/28673/28674 M5:3 — Mate:65, Mate:66, Angle:10
275. DIN 934 - replaced by DIN EN 24032/28673/28674 M5:2 — Mate:63, Mate:64, Angle:9
276. DIN 912 - replaced by DIN EN ISO 4762 M5 x 50:8 — Mate:59, Mate:60
277. DIN 912 - replaced by DIN EN ISO 4762 M5 x 50:7 — Mate:57, Mate:58
278. DIN 912 - replaced by DIN EN ISO 4762 M5 x 50:6 — Mate:55, Mate:56
279. DIN 912 - replaced by DIN EN ISO 4762 M5 x 50:5 — Mate:53, Mate:54
280. DIN 912 - replaced by DIN EN ISO 4762 M5 x 50:4 — Mate:51, Mate:52
281. DIN 912 - replaced by DIN EN ISO 4762 M5 x 50:3 — Mate:49, Mate:50
282. DIN 912 - replaced by DIN EN ISO 4762 M5 x 50:2 — Mate:47, Mate:48
283. DIN 934 - replaced by DIN EN 24032/28673/28674 M5:1 — Mate:61, Mate:62, Angle:16
284. DIN 912 - replaced by DIN EN ISO 4762 M5 x 50:1 — Mate:45, Mate:46
285. ISO 7380-1 M4 x 40:1 — Mate:8, Mate:9
286. DIN 934 - replaced by DIN EN 24032/28673/28674 M4:1 — Mate:24, Mate:25, Angle:8
287. ISO 7380-1 M4 x 40:2 — Mate:10, Mate:11
288. ISO 7380-1 M4 x 40:3 — Mate:12, Mate:13
289. ISO 7380-1 M4 x 40:4 — Mate:14, Mate:15
290. ISO 7380-1 M4 x 40:5 — Mate:16, Mate:17
291. ISO 7380-1 M4 x 40:6 — Mate:18, Mate:19
292. ISO 7380-1 M4 x 40:7 — Mate:20, Mate:21
293. ISO 7380-1 M4 x 40:8 — Mate:22, Mate:23
294. DIN 934 - replaced by DIN EN 24032/28673/28674 M4:2 — Mate:26, Mate:27, Angle:1
295. DIN 934 - replaced by DIN EN 24032/28673/28674 M4:3 — Mate:28, Mate:29, Angle:2
296. DIN 934 - replaced by DIN EN 24032/28673/28674 M4:4 — Mate:30, Mate:31, Angle:3
297. DIN 934 - replaced by DIN EN 24032/28673/28674 M4:5 — Mate:32, Mate:33, Angle:4
298. DIN 934 - replaced by DIN EN 24032/28673/28674 M4:6 — Mate:34, Mate:35, Angle:5
299. DIN 934 - replaced by DIN EN 24032/28673/28674 M4:7 — Mate:36, Mate:37, Angle:6
300. DIN 934 - replaced by DIN EN 24032/28673/28674 M4:8 — Mate:38, Mate:39, Angle:7
301. COTS_PROFOTO_Tripod_Sandbag:1 — Mate:560, Mate:561, Mate:562
302. COTS_PROFOTO_Tripod_Sandbag:2
303. COTS_PROFOTO_Tripod_Sandbag:3
304. DIN 912 - replaced by DIN EN ISO 4762 M5 x 20:1 — Mate:558, Mate:559
305. COTS_BOSSARD_1386786_M5_Threaded_Insert:1 — Mate:556, Mate:557, Mate:558, Mate:559
306. DIN 912 - replaced by DIN EN ISO 4762 M5 x 20:2
307. COTS_BOSSARD_1386786_M5_Threaded_Insert:2
308. DIN 912 - replaced by DIN EN ISO 4762 M5 x 20:3
309. COTS_BOSSARD_1386786_M5_Threaded_Insert:3
310. DIN 912 - replaced by DIN EN ISO 4762 M5 x 20:4